# Autodesk Inventor assembly: MM0948AN002_G10_001
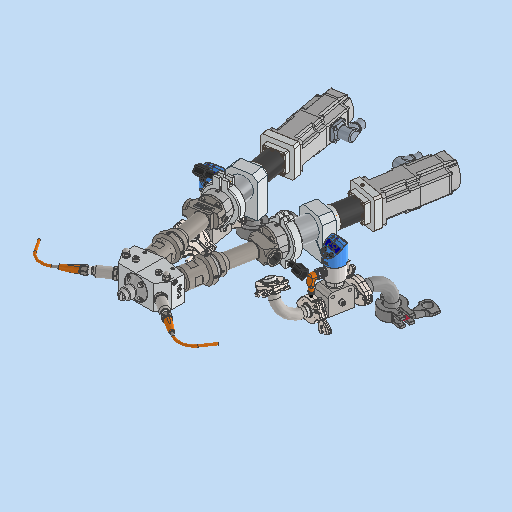
[picture p0: Inventor's stored thumbnail of the model, 512x512]
Saved by Autodesk Inventor 2023.3 (Build 273359000, 359)
## iProperties
RuleStatus: InUse
Created: 2022-12-20
Part Number: MM0948AN002_G10_001
Description: =<RBPARTNOTITLE2>
Document SubType Name: Assembly
Designer: ric7an
Mass: 11235.9 g
Surface Area: 7483.87 cm^2
Volume: 2488.55 cm^3
Density: 4.51505 g/cm^3
RBPARTMADEOF: --
RBDRAWINGMISSINGSPEC: --
AnP_Kategorie: 99
RBPARTNOTITLE2: Dispenskopf Viscotec VM12/12
RBSURFACE: --
RBPARTNOTITLE1: Dispenshead Viscotec VM12/12
AnP_Material: =<Material>
RBMATERIAL: =<Material>
RBMATNO: =<Part Number>
RBPARTNO: SIEHE MNR
Author: ric7an
Keywords: =<RBPARTMADEOF>
Comments: =<RBSURFACE2>
Revision Number: 01
## Documents named in this file (7)
- C:\Users\rea9an\Documents\Inventor\TCAI2412_te1910_EM\AS00000926.iam
- C:\Users\rea9an\Documents\Inventor\TCAI2412_te1910_EM\PT00004528.ipt
- C:\Users\rea9an\Documents\Inventor\TCAI2412_te1910_EM\PT00004765.ipt
- C:\Users\rea9an\Documents\Inventor\TCAI2412_te1910_EM\PT00004529.ipt
- C:\Users\rea9an\Documents\Inventor\TCAI2412_te1910_EM\AS00000927.iam
- C:\Users\rea9an\Documents\Inventor\TCAI2412_te1910_EM\AS00000928.iam
- C:\Users\rea9an\Documents\Inventor\TCAI2412_te1910_EM\PT00004530.ipt
## Components (11 placed, 6 different names)
1. PT00004528:1
2. PT00004528:2
3. PT00004765:1
4. PT00004765:2
5. PT00004529:1 — Einfügen:5
6. PT00004529:2 — Einfügen:4
7. AS00000927:1 [sub-assembly]
8. AS00000928:1 [sub-assembly]
9. AS00000928:2 [sub-assembly]
10. PT00004530:1 — Einfügen:4
11. PT00004530:2 — Einfügen:5
## Relationships (25: Mate 14, Insert 5, Angle 5, Flush 1)
- [Mate]: PT00004765:1 ↔ AS00000927:1
- [Mate]: PT00004765:1 ↔ AS00000927:1
- [Insert]: PT00004765:2 ↔ AS00000927:1
- [Insert]: PT00004528:2 ↔ PT00004529:2
- [Insert]: PT00004528:1 ↔ PT00004529:1
- [Mate]: PT00004528:2 ↔ PT00004529:2
- [Mate]: PT00004528:1 ↔ PT00004529:1
- [Mate]: PT00004765:2 ↔ PT00004529:2
- [Mate]: PT00004765:2 ↔ PT00004529:2
- [Angle] (0 deg): PT00004529:2 ↔ AS00000927:1
- [Mate]: PT00004765:1 ↔ PT00004529:1
- [Mate]: PT00004765:1 ↔ PT00004529:1
- [Angle] (0 deg): PT00004529:1 ↔ AS00000927:1
- [Flush]: AS00000927:1
- [Mate]: PT00004765:2 ↔ AS00000927:1
- [Mate]: PT00004765:1 ↔ AS00000927:1
- [Angle] (180 deg): AS00000927:1
- [Mate]: AS00000927:1 ↔ AS00000928:1
- [Mate]: AS00000927:1 ↔ AS00000928:2
- [Mate]: AS00000927:1 ↔ AS00000928:2
- [Mate]: AS00000927:1 ↔ AS00000928:1
- [Angle] (180 deg): AS00000927:1 ↔ AS00000928:2
- [Angle] (180 deg): AS00000927:1 ↔ AS00000928:1
- Einfügen:4 [Insert] (-11.7 mm): PT00004529:2 ↔ PT00004530:1
- Einfügen:5 [Insert] (-11.7 mm): PT00004529:1 ↔ PT00004530:2
## Named parameters: d54_d46 = 0 mm, d55_d47 = 0 mm, d56_d48 = 180 deg
